# Autodesk Inventor assembly: Montagem1
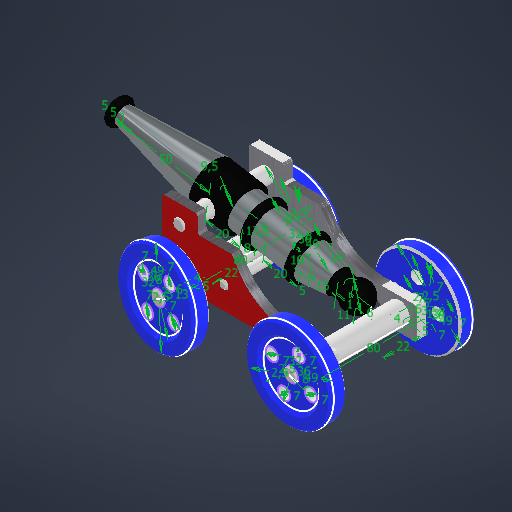
[picture p0: Inventor's stored thumbnail of the model, 512x512]
Saved by Autodesk Inventor 2026.2 (Build 302298000, 298)
## iProperties
Created: 2026-08-28
Part Number: Montagem1
Document SubType Name: Assembly
Designer: IFSP
Author: IFSP
## Documents named in this file (7)
- D:\Montagem1.iam
- D:\apoiozinho1.ipt
- D:\bagacinho.ipt
- D:\canhazinho.ipt
- D:\Pecinha maios simples1.ipt
- D:\Rodadebotao.ipt
- D:\ultima pecinha.ipt
## Components (11 placed, 6 different names)
1. apoiozinho1:1 — Coincidente:1, Coincidente:2, Coincidente:3, Coincidente:4, Coincidente:5, Coincidente:6, Coincidente:7, Coincidente:8
2. apoiozinho1:2 — Coincidente:10, Coincidente:11
3. bagacinho:1 — Coincidente:5, Coincidente:6, Coincidente:9
4. canhazinho:1 — Coincidente:9, Tangente:1
5. Pecinha maios simples1:1 — Coincidente:7, Coincidente:8, Tangente:1
6. Rodadebotao:1 — Coincidente:13
7. Rodadebotao:3 — Coincidente:14
8. Rodadebotao:4 — Coincidente:15, Coincidente:16
9. ultima pecinha:1 — Coincidente:1, Coincidente:2, Coincidente:10, Coincidente:11, Coincidente:12, Coincidente:14
10. ultima pecinha:2 — Coincidente:3, Coincidente:4, Coincidente:13, Coincidente:15, Coincidente:16
11. Rodadebotao:5 — Coincidente:12
## Relationships (17: Mate 16, Tangent 1)
- Coincidente:1 [Mate]: apoiozinho1:1 ↔ ultima pecinha:1
- Coincidente:2 [Mate]: apoiozinho1:1 ↔ ultima pecinha:1
- Coincidente:3 [Mate]: apoiozinho1:1 ↔ ultima pecinha:2
- Coincidente:4 [Mate]: apoiozinho1:1 ↔ ultima pecinha:2
- Coincidente:5 [Mate]: apoiozinho1:1 ↔ bagacinho:1
- Coincidente:6 [Mate]: apoiozinho1:1 ↔ bagacinho:1
- Coincidente:7 [Mate]: apoiozinho1:1 ↔ Pecinha maios simples1:1
- Coincidente:8 [Mate]: apoiozinho1:1 ↔ Pecinha maios simples1:1
- Coincidente:9 [Mate]: bagacinho:1 ↔ canhazinho:1
- Tangente:1: canhazinho:1 ↔ Pecinha maios simples1:1
- Coincidente:10 [Mate]: apoiozinho1:2 ↔ ultima pecinha:1
- Coincidente:11 [Mate]: apoiozinho1:2 ↔ ultima pecinha:1
- Coincidente:12 [Mate]: ultima pecinha:1 ↔ Rodadebotao:5
- Coincidente:13 [Mate]: Rodadebotao:1 ↔ ultima pecinha:2
- Coincidente:14 [Mate]: Rodadebotao:3 ↔ ultima pecinha:1
- Coincidente:15 [Mate]: Rodadebotao:4 ↔ ultima pecinha:2
- Coincidente:16 [Mate]: Rodadebotao:4 ↔ ultima pecinha:2
## Named parameters: Finish1_Area = 93.5242, Finish1_Depth = 0.03 mm, Finish2_Area = 27.7965, Finish2_Thickness = 0.008 mm, Finish3_Area = 25.7626, Finish3_Thickness = 0.008 mm, Finish4_Area = 52.5089, Finish4_Thickness = 0.008 mm, Finish5_Area = 44.3173, Finish5_Thickness = 0.05 mm, Finish6_Area = 147.017
note: some values were not read from the file. Shown as the stored number, unit unknown: "Finish1_Area", "Finish2_Area", "Finish3_Area", "Finish4_Area", "Finish5_Area", "Finish6_Area".
